# Autodesk Inventor assembly: 2_13_asm_truc_v2
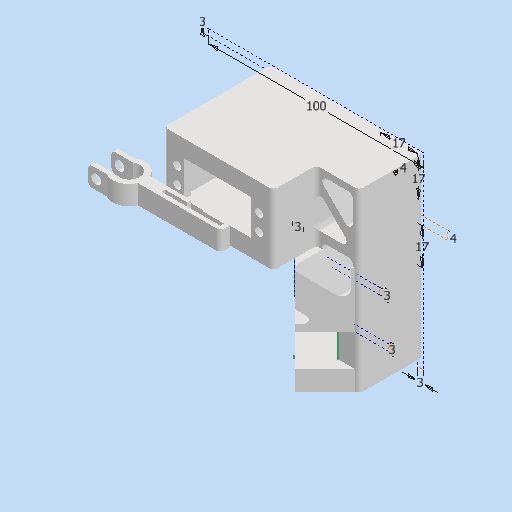
[picture p0: Inventor's stored thumbnail of the model, 512x512]
Saved by Autodesk Inventor 2026 (Build 300175050, 175E)
## iProperties
Created: 2025-06-22
Part Number: 2_13_asm_truc_v2
Document SubType Name: Assembly
Designer: Diogo
Author: Diogo
## Documents named in this file (3)
- C:\Users\karle\OneDrive - HESSO\P2511_Dossier_partage_RVEZ\01_Robot\0101_CAO\2_Stabil\2_13_asm_truc_v2.iam
- C:\Users\karle\OneDrive - HESSO\P2511_Dossier_partage_RVEZ\01_Robot\0101_CAO\2_Stabil\2_11_support_truc_tuyauv2.ipt
- C:\Users\karle\OneDrive - HESSO\P2511_Dossier_partage_RVEZ\01_Robot\0101_CAO\2_Stabil\2_12_bras_truc_tuyauv2.ipt
## Components (2 placed, 2 different names)
1. 2_11_support_truc_tuyauv2:1 — Passend:1, Passend:2, Winkel:1
2. 2_12_bras_truc_tuyauv2:1 — Passend:1
## Relationships (3: Mate 2, Angle 1)
- Passend:1 [Mate] (8 mm): 2_11_support_truc_tuyauv2:1 ↔ 2_12_bras_truc_tuyauv2:1
- Passend:2 [Mate]: 2_11_support_truc_tuyauv2:1
- Winkel:1 [Angle] (45 deg): 2_11_support_truc_tuyauv2:1
